# Autodesk Inventor assembly: disc 2
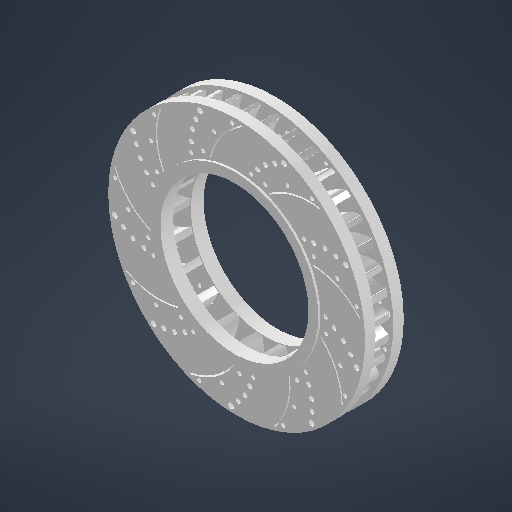
[picture p0: Inventor's stored thumbnail of the model, 512x512]
Saved by Autodesk Inventor 2027 (Build 310192060, 192F)
## iProperties
Created: 2026-07-10
Part Number: disc 2
Document SubType Name: Assembly
Designer: ElieH
Author: ElieH
## Documents named in this file (4)
- C:\Users\ElieH\Desktop\New folder (3)\disc 2.iam
- C:\Users\ElieH\Desktop\disks\disc2 front face.ipt
- C:\Users\ElieH\Desktop\disks\cooling fins.ipt
- C:\Users\ElieH\Desktop\disks\disc3 back face side.ipt
## Components (3 placed, 3 different names)
1. disc2 front face:1 — Mate:1
2. cooling fins:1 — Mate:1, Mate:2, Mate:3
3. disc3 back face side:1 — Mate:2, Mate:3
## Relationships (3: Mate 3)
- Mate:1: disc2 front face:1 ↔ cooling fins:1
- Mate:2: cooling fins:1 ↔ disc3 back face side:1
- Mate:3: cooling fins:1 ↔ disc3 back face side:1
